# Autodesk Inventor assembly: MM0948AN170_G00_801
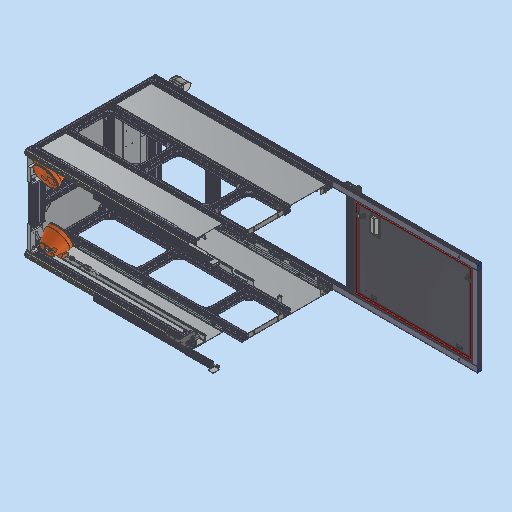
[picture p0: Inventor's stored thumbnail of the model, 512x512]
Saved by Autodesk Inventor 2023.3 (Build 273359000, 359)
## iProperties
RuleStatus: InUse
Created: 2021-06-24
Part Number: MM0948AN170_G00_801
Description: =<RBPARTNOTITLE2>
Document SubType Name: Assembly
Designer: frt9bw
Mass: 78853.5 g
Surface Area: 247356 cm^2
Volume: 30250.6 cm^3
Density: 2.60667 g/cm^3
AnP_Kategorie: 1
AnP_Material: =<Material>
AnP_TemplVers: 20200821
RBDOCUMENTTYPE: DRF
RBDOCUMENTVERSION: 00
RBDRAWINGMAINSCALE: 1:1
RBDRAWINGMISSINGSPEC: --
RBDRAWINGVOLUME: --
RBDSV1: 0850
RBGBEDGESIN1: +0,5
RBGBEDGESIN2: +0,2
RBGBEDGESOUT1: -0,3
RBGBEDGESOUT2: -0,1
RBMATERIAL: =<Material>
RBMATMEETS: --
RBMATNO: =<Part Number>
RBPARTMADEOF: --
RBPARTNO: SIEHE MNR
RBPARTNOTITLE1: manufactured part
RBPARTNOTITLE2: Blechsatz Einfachhaube
RBPARTSAFETYINDICATOR: --
RBSURFACE: --
RBSURFACE2: --
RBZEDGESNORM: ISO13715:2002-06
RBZGENDIMCLASS: m
RBZGENDIMNORM: ISO 2768-1:1989-11
RBZGENGEOCLASS: H
RBZGENGEONORM: ISO 2768-2:1989-11
RBZSURFACENORM: ISO13D2:2002-02
RBZTOLERANCENORM: ISO 14405-1:2010-12
Author: frt9bw
Keywords: =<RBPARTMADEOF>
Comments: =<RBSURFACE2>
Revision Number: 01
## Documents named in this file (19)
- C:\Users\rea9an\Documents\Inventor\TCAI2412_te1910_EM\AS00000962.iam
- C:\Users\rea9an\Documents\Inventor\TCAI2412_te1910_EM\PT00004288.ipt
- C:\Users\rea9an\Documents\Inventor\TCAI2412_te1910_EM\PT00004303.ipt
- C:\Users\rea9an\Documents\Inventor\TCAI2412_te1910_EM\PT00004480.ipt
- C:\Users\rea9an\Documents\Inventor\TCAI2412_te1910_EM\PT00004311.ipt
- C:\Users\rea9an\Documents\Inventor\TCAI2412_te1910_EM\PT00004406.ipt
- C:\Users\rea9an\Documents\Inventor\TCAI2412_te1910_EM\PT00004797.ipt
- C:\Users\rea9an\Documents\Inventor\TCAI2412_te1910_EM\PT00004798.ipt
- C:\Users\rea9an\Documents\Inventor\TCAI2412_te1910_EM\PT00004457.ipt
- C:\Users\rea9an\Documents\Inventor\TCAI2412_te1910_EM\PT00004800.ipt
- C:\Users\rea9an\Documents\Inventor\TCAI2412_te1910_EM\PT00004806.ipt
- C:\Users\rea9an\Documents\Inventor\TCAI2412_te1910_EM\PT00004456.ipt
- C:\Users\rea9an\Documents\Inventor\TCAI2412_te1910_EM\PT00004805.ipt
- C:\Users\rea9an\Documents\Inventor\TCAI2412_te1910_EM\PT00004804.ipt
- C:\Users\rea9an\Documents\Inventor\TCAI2412_te1910_EM\AS00000914.iam
- C:\Users\rea9an\Documents\Inventor\TCAI2412_te1910_EM\PT00004331.ipt
- C:\Users\rea9an\Documents\Inventor\TCAI2412_te1910_EM\AS00000920.iam
- C:\Users\rea9an\Documents\Inventor\TCAI2412_te1910_EM\PT00004702.ipt
- C:\Users\rea9an\Documents\Inventor\TCAI2412_te1910_EM\AS00000921.iam
## Components (145 placed, 18 different names)
1. PT00004702:1 — Fluchtend:6, Fluchtend:7, Passend:2, Fluchtend:10, Passend:4, Einfügen:2, Einfügen:11, Einfügen:12, Einfügen:13, Einfügen:14, Einfügen:15, Einfügen:33, Einfügen:34, Einfügen:35, Einfügen:36, Einfügen:37, Einfügen:38, Fluchtend:22, Fluchtend:24, Fluchtend:45, Fluchtend:58
2. PT00004702:2 — Fluchtend:15, Passend:7, Fluchtend:16, Fluchtend:17, Fluchtend:18, Einfügen:47, Einfügen:49, Einfügen:51, Einfügen:53, Einfügen:55, Einfügen:57, Einfügen:87, Einfügen:88, Einfügen:89, Einfügen:90, Einfügen:91, Einfügen:92, Fluchtend:22, Fluchtend:24, Passend:20
3. AS00000921:1 [sub-assembly] — Passend:35, Passend:38, Fluchtend:71, Fluchtend:72
4. AS00000914:1 [sub-assembly] — Fluchtend:27, Passend:13, Passend:14, Passend:30, Passend:32
5. PT00004797:1 — Fluchtend:1, Fluchtend:2, Fluchtend:3, Fluchtend:6, Fluchtend:7, Passend:2, Einfügen:16, Einfügen:17, Einfügen:18, Einfügen:26, Einfügen:29, Einfügen:32, Einfügen:39, Einfügen:41, Einfügen:43, Einfügen:45, Fluchtend:25, Fluchtend:40
6. PT00004798:1 — Fluchtend:1, Fluchtend:2, Fluchtend:3, Einfügen:27, Einfügen:28, Einfügen:30, Einfügen:31, Einfügen:40, Einfügen:42, Einfügen:44, Einfügen:46
7. PT00004797:2 — Passend:5, Passend:6, Fluchtend:11, Fluchtend:16, Fluchtend:17, Fluchtend:18, Einfügen:59, Einfügen:61, Einfügen:63, Einfügen:65, Einfügen:71, Einfügen:77, Einfügen:79, Einfügen:81, Einfügen:83, Einfügen:85, Fluchtend:20, Fluchtend:21, Fluchtend:25, Fluchtend:27, Passend:14, Fluchtend:42
8. PT00004798:2 — Passend:5, Passend:6, Fluchtend:11, Einfügen:67, Einfügen:69, Einfügen:73, Einfügen:75, Fluchtend:20, Fluchtend:21, Einfügen:93, Einfügen:94, Einfügen:95, Einfügen:96
9. PT00004457:1 — Fluchtend:34, Fluchtend:36, Fluchtend:44, Fluchtend:56
10. PT00004457:2 — Fluchtend:34, Passend:20, Fluchtend:36, Fluchtend:52, Fluchtend:57
11. PT00004800:1 — Passend:21, Fluchtend:39, Fluchtend:41, Einfügen:110, Einfügen:111, Einfügen:114, Einfügen:115, Einfügen:118, Einfügen:119, Einfügen:120, Einfügen:121, Passend:25, Passend:35
12. PT00004800:2 — Passend:21, Fluchtend:39, Fluchtend:40, Fluchtend:41, Fluchtend:42, Einfügen:112, Einfügen:113, Einfügen:116, Einfügen:117, Einfügen:126, Einfügen:127, Einfügen:128, Einfügen:129, Passend:26
13. PT00004806:1 — Passend:25, Fluchtend:45, Passend:26
14. PT00004456:1 — Fluchtend:52, Fluchtend:53, Fluchtend:54, Fluchtend:56
15. PT00004456:2 — Fluchtend:53, Fluchtend:54, Fluchtend:57, Fluchtend:58
16. PT00004805:1 — Passend:30
17. PT00004804:1 — Passend:32
18. PT00004456:4
19. PT00004456:3
20. AS00000920:1 [sub-assembly]
21. PT00004331:1 — Passend:38, Fluchtend:71, Fluchtend:72
22. PT00004480:15 — Einfügen:113
23. PT00004311:15
24. PT00004480:16 — Einfügen:112
25. PT00004311:16
26. PT00004480:17 — Einfügen:111
27. PT00004311:17
28. PT00004480:18 — Einfügen:110
29. PT00004311:18
30. PT00004480:19 — Einfügen:114
31. PT00004311:19
32. PT00004480:20 — Einfügen:117
33. PT00004311:20
34. PT00004480:21 — Einfügen:120
35. PT00004311:21
36. PT00004480:22 — Einfügen:121
37. PT00004311:22
38. PT00004480:23 — Einfügen:119
39. PT00004311:23
40. PT00004480:24 — Einfügen:118
41. PT00004311:24
42. PT00004480:25 — Einfügen:116
43. PT00004311:25
44. PT00004480:26 — Einfügen:115
45. PT00004311:26
46. PT00004480:27 — Einfügen:126
47. PT00004311:27
48. PT00004480:28 — Einfügen:128
49. PT00004311:28
50. PT00004480:29 — Einfügen:129
51. PT00004311:29
52. PT00004480:30 — Einfügen:127
53. PT00004311:30
54. PT00004406:15 — Einfügen:79
55. PT00004406:17 — Einfügen:81
56. PT00004406:19 — Einfügen:83
57. PT00004406:21 — Einfügen:85
58. PT00004406:23 — Einfügen:87
59. PT00004406:24 — Einfügen:88
60. PT00004406:25 — Einfügen:89
61. PT00004406:26 — Einfügen:90
62. PT00004406:27 — Einfügen:91
63. PT00004406:28 — Einfügen:92
64. PT00004406:29 — Einfügen:96
65. PT00004406:30 — Einfügen:95
66. PT00004406:31 — Einfügen:94
67. PT00004406:32 — Einfügen:93
68. PT00004303:10 — Einfügen:48
69. PT00004288:11 — Einfügen:47, Einfügen:48
70. PT00004303:11 — Einfügen:50
71. PT00004288:12 — Einfügen:49, Einfügen:50
72. PT00004303:12 — Einfügen:52
73. PT00004288:13 — Einfügen:51, Einfügen:52
74. PT00004303:13 — Einfügen:54
75. PT00004288:14 — Einfügen:53, Einfügen:54
76. PT00004303:14 — Einfügen:56
77. PT00004288:15 — Einfügen:55, Einfügen:56
78. PT00004303:15 — Einfügen:58
79. PT00004288:16 — Einfügen:57, Einfügen:58
80. PT00004303:16 — Einfügen:60
81. PT00004288:17 — Einfügen:59, Einfügen:60
82. PT00004303:17 — Einfügen:62
83. PT00004288:18 — Einfügen:61, Einfügen:62
84. PT00004303:18 — Einfügen:64
85. PT00004288:19 — Einfügen:63, Einfügen:64
86. PT00004480:8 — Einfügen:65, Einfügen:66
87. PT00004311:8 — Einfügen:66
88. PT00004480:9 — Einfügen:67, Einfügen:68
89. PT00004311:9 — Einfügen:68
90. PT00004480:10 — Einfügen:69, Einfügen:70
91. PT00004311:10 — Einfügen:70
92. PT00004480:11 — Einfügen:71, Einfügen:72
93. PT00004311:11 — Einfügen:72
94. PT00004480:12 — Einfügen:73, Einfügen:74
95. PT00004311:12 — Einfügen:74
96. PT00004480:13 — Einfügen:75, Einfügen:76
97. PT00004311:13 — Einfügen:76
98. PT00004480:14 — Einfügen:77, Einfügen:78
99. PT00004311:14 — Einfügen:78
100. PT00004303:1
101. PT00004288:2 — Einfügen:2
102. PT00004303:2
103. PT00004288:3 — Einfügen:12
104. PT00004303:3
105. PT00004288:4 — Einfügen:11
106. PT00004303:4
107. PT00004288:5 — Einfügen:13
108. PT00004303:5
109. PT00004288:6 — Einfügen:14
110. PT00004303:6
111. PT00004288:7 — Einfügen:15
112. PT00004303:7
113. PT00004288:8 — Einfügen:16
114. PT00004303:8
115. PT00004288:9 — Einfügen:17
116. PT00004303:9
117. PT00004288:10 — Einfügen:18
118. PT00004480:1 — Einfügen:32
119. PT00004311:1
120. PT00004480:2 — Einfügen:31
121. PT00004311:2
122. PT00004480:3 — Einfügen:30
123. PT00004311:3
124. PT00004480:4 — Einfügen:29
125. PT00004311:4
126. PT00004480:5 — Einfügen:28
127. PT00004311:5
128. PT00004480:6 — Einfügen:27
129. PT00004311:6
130. PT00004480:7 — Einfügen:26
131. PT00004311:7
132. PT00004406:1 — Einfügen:45
133. PT00004406:2 — Einfügen:46
134. PT00004406:3 — Einfügen:43
135. PT00004406:4 — Einfügen:44
136. PT00004406:5 — Einfügen:41
137. PT00004406:6 — Einfügen:42
138. PT00004406:7 — Einfügen:39
139. PT00004406:8 — Einfügen:40
140. PT00004406:9 — Einfügen:37
141. PT00004406:10 — Einfügen:38
142. PT00004406:11 — Einfügen:35
143. PT00004406:12 — Einfügen:36
144. PT00004406:13 — Einfügen:33
145. PT00004406:14 — Einfügen:34
## Relationships (185: Insert 124, Flush 42, Mate 19)
- Fluchtend:1 [Flush]: PT00004797:1 ↔ PT00004798:1
- Fluchtend:2 [Flush]: PT00004797:1 ↔ PT00004798:1
- Fluchtend:3 [Flush]: PT00004797:1 ↔ PT00004798:1
- Fluchtend:6 [Flush]: PT00004702:1 ↔ PT00004797:1
- Fluchtend:7 [Flush]: PT00004702:1 ↔ PT00004797:1
- Passend:2 [Mate] (377 mm): PT00004702:1 ↔ PT00004797:1
- Fluchtend:10 [Flush] (-365 mm): PT00004702:1
- Passend:4 [Mate] (-45 mm): PT00004702:1
- [Insert] (5 mm): PT00004303:1 ↔ PT00004288:2
- Einfügen:2 [Insert]: PT00004702:1 ↔ PT00004288:2
- [Insert] (5 mm): PT00004303:2 ↔ PT00004288:3
- [Insert] (5 mm): PT00004303:3 ↔ PT00004288:4
- [Insert] (5 mm): PT00004303:4 ↔ PT00004288:5
- [Insert] (5 mm): PT00004303:5 ↔ PT00004288:6
- [Insert] (5 mm): PT00004303:6 ↔ PT00004288:7
- [Insert] (5 mm): PT00004303:7 ↔ PT00004288:8
- [Insert] (5 mm): PT00004303:8 ↔ PT00004288:9
- [Insert] (5 mm): PT00004303:9 ↔ PT00004288:10
- Einfügen:11 [Insert]: PT00004702:1 ↔ PT00004288:4
- Einfügen:12 [Insert]: PT00004702:1 ↔ PT00004288:3
- Einfügen:13 [Insert]: PT00004702:1 ↔ PT00004288:5
- Einfügen:14 [Insert]: PT00004702:1 ↔ PT00004288:6
- Einfügen:15 [Insert]: PT00004702:1 ↔ PT00004288:7
- Einfügen:16 [Insert]: PT00004797:1 ↔ PT00004288:8
- Einfügen:17 [Insert]: PT00004797:1 ↔ PT00004288:9
- Einfügen:18 [Insert]: PT00004797:1 ↔ PT00004288:10
- [Insert] (5 mm): PT00004480:1 ↔ PT00004311:1
- [Insert] (5 mm): PT00004480:2 ↔ PT00004311:2
- [Insert] (5 mm): PT00004480:3 ↔ PT00004311:3
- [Insert] (5 mm): PT00004480:4 ↔ PT00004311:4
- [Insert] (5 mm): PT00004480:5 ↔ PT00004311:5
- [Insert] (5 mm): PT00004480:6 ↔ PT00004311:6
- [Insert] (5 mm): PT00004480:7 ↔ PT00004311:7
- Einfügen:26 [Insert]: PT00004797:1 ↔ PT00004480:7
- Einfügen:27 [Insert]: PT00004798:1 ↔ PT00004480:6
- Einfügen:28 [Insert]: PT00004798:1 ↔ PT00004480:5
- Einfügen:29 [Insert]: PT00004797:1 ↔ PT00004480:4
- Einfügen:30 [Insert]: PT00004798:1 ↔ PT00004480:3
- Einfügen:31 [Insert]: PT00004798:1 ↔ PT00004480:2
- Einfügen:32 [Insert]: PT00004797:1 ↔ PT00004480:1
- Einfügen:33 [Insert] (2 mm): PT00004702:1 ↔ PT00004406:13
- Einfügen:34 [Insert] (2 mm): PT00004702:1 ↔ PT00004406:14
- Einfügen:35 [Insert] (2 mm): PT00004702:1 ↔ PT00004406:11
- Einfügen:36 [Insert] (2 mm): PT00004702:1 ↔ PT00004406:12
- Einfügen:37 [Insert] (2 mm): PT00004702:1 ↔ PT00004406:9
- Einfügen:38 [Insert] (2 mm): PT00004702:1 ↔ PT00004406:10
- Einfügen:39 [Insert] (2 mm): PT00004797:1 ↔ PT00004406:7
- Einfügen:40 [Insert] (2 mm): PT00004798:1 ↔ PT00004406:8
- Einfügen:41 [Insert] (2 mm): PT00004797:1 ↔ PT00004406:5
- Einfügen:42 [Insert] (2 mm): PT00004798:1 ↔ PT00004406:6
- Einfügen:43 [Insert] (2 mm): PT00004797:1 ↔ PT00004406:3
- Einfügen:44 [Insert] (2 mm): PT00004798:1 ↔ PT00004406:4
- Einfügen:45 [Insert] (2 mm): PT00004797:1 ↔ PT00004406:1
- Einfügen:46 [Insert] (2 mm): PT00004798:1 ↔ PT00004406:2
- Passend:5 [Mate]: PT00004797:2 ↔ PT00004798:2
- Passend:6 [Mate]: PT00004797:2 ↔ PT00004798:2
- Fluchtend:11 [Flush]: PT00004797:2 ↔ PT00004798:2
- Fluchtend:15 [Flush] (-45 mm): PT00004702:2
- Passend:7 [Mate] (365 mm): PT00004702:2
- Fluchtend:16 [Flush] (377 mm): PT00004702:2 ↔ PT00004797:2
- Fluchtend:17 [Flush]: PT00004702:2 ↔ PT00004797:2
- Fluchtend:18 [Flush]: PT00004702:2 ↔ PT00004797:2
- Einfügen:47 [Insert]: PT00004702:2 ↔ PT00004288:11
- Einfügen:48 [Insert] (5 mm): PT00004303:10 ↔ PT00004288:11
- Einfügen:49 [Insert]: PT00004702:2 ↔ PT00004288:12
- Einfügen:50 [Insert] (5 mm): PT00004303:11 ↔ PT00004288:12
- Einfügen:51 [Insert]: PT00004702:2 ↔ PT00004288:13
- Einfügen:52 [Insert] (5 mm): PT00004303:12 ↔ PT00004288:13
- Einfügen:53 [Insert]: PT00004702:2 ↔ PT00004288:14
- Einfügen:54 [Insert] (5 mm): PT00004303:13 ↔ PT00004288:14
- Einfügen:55 [Insert]: PT00004702:2 ↔ PT00004288:15
- Einfügen:56 [Insert] (5 mm): PT00004303:14 ↔ PT00004288:15
- Einfügen:57 [Insert]: PT00004702:2 ↔ PT00004288:16
- Einfügen:58 [Insert] (5 mm): PT00004303:15 ↔ PT00004288:16
- Einfügen:59 [Insert]: PT00004797:2 ↔ PT00004288:17
- Einfügen:60 [Insert] (5 mm): PT00004303:16 ↔ PT00004288:17
- Einfügen:61 [Insert]: PT00004797:2 ↔ PT00004288:18
- Einfügen:62 [Insert] (5 mm): PT00004303:17 ↔ PT00004288:18
- Einfügen:63 [Insert]: PT00004797:2 ↔ PT00004288:19
- Einfügen:64 [Insert] (5 mm): PT00004303:18 ↔ PT00004288:19
- Einfügen:65 [Insert]: PT00004797:2 ↔ PT00004480:8
- Einfügen:66 [Insert] (5 mm): PT00004480:8 ↔ PT00004311:8
- Einfügen:67 [Insert]: PT00004798:2 ↔ PT00004480:9
- Einfügen:68 [Insert] (5 mm): PT00004480:9 ↔ PT00004311:9
- Einfügen:69 [Insert]: PT00004798:2 ↔ PT00004480:10
- Einfügen:70 [Insert] (5 mm): PT00004480:10 ↔ PT00004311:10
- Einfügen:71 [Insert]: PT00004797:2 ↔ PT00004480:11
- Einfügen:72 [Insert] (5 mm): PT00004480:11 ↔ PT00004311:11
- Einfügen:73 [Insert]: PT00004798:2 ↔ PT00004480:12
- Einfügen:74 [Insert] (5 mm): PT00004480:12 ↔ PT00004311:12
- Einfügen:75 [Insert]: PT00004798:2 ↔ PT00004480:13
- Einfügen:76 [Insert] (5 mm): PT00004480:13 ↔ PT00004311:13
- Einfügen:77 [Insert]: PT00004797:2 ↔ PT00004480:14
- Einfügen:78 [Insert] (5 mm): PT00004480:14 ↔ PT00004311:14
- Einfügen:79 [Insert] (2 mm): PT00004797:2 ↔ PT00004406:15
- Einfügen:81 [Insert] (2 mm): PT00004797:2 ↔ PT00004406:17
- Einfügen:83 [Insert] (2 mm): PT00004797:2 ↔ PT00004406:19
- Einfügen:85 [Insert] (2 mm): PT00004797:2 ↔ PT00004406:21
- Einfügen:87 [Insert] (2 mm): PT00004702:2 ↔ PT00004406:23
- Einfügen:88 [Insert] (2 mm): PT00004702:2 ↔ PT00004406:24
- Einfügen:89 [Insert] (2 mm): PT00004702:2 ↔ PT00004406:25
- Einfügen:90 [Insert] (2 mm): PT00004702:2 ↔ PT00004406:26
- Einfügen:91 [Insert] (2 mm): PT00004702:2 ↔ PT00004406:27
- Einfügen:92 [Insert] (2 mm): PT00004702:2 ↔ PT00004406:28
- Fluchtend:20 [Flush]: PT00004797:2 ↔ PT00004798:2
- Fluchtend:21 [Flush]: PT00004797:2 ↔ PT00004798:2
- Fluchtend:22 [Flush]: PT00004702:1 ↔ PT00004702:2
- Fluchtend:24 [Flush]: PT00004702:1 ↔ PT00004702:2
- Einfügen:93 [Insert] (2 mm): PT00004798:2 ↔ PT00004406:32
- Einfügen:94 [Insert] (2 mm): PT00004798:2 ↔ PT00004406:31
- Einfügen:95 [Insert] (2 mm): PT00004798:2 ↔ PT00004406:30
- Einfügen:96 [Insert] (2 mm): PT00004798:2 ↔ PT00004406:29
- Fluchtend:25 [Flush]: PT00004797:1 ↔ PT00004797:2
- Fluchtend:27 [Flush]: AS00000914:1 ↔ PT00004797:2
- Passend:13 [Mate]: AS00000914:1
- Passend:14 [Mate] (45 mm): AS00000914:1 ↔ PT00004797:2
- Fluchtend:34 [Flush]: PT00004457:1 ↔ PT00004457:2
- Passend:20 [Mate] (45 mm): PT00004702:2 ↔ PT00004457:2
- Fluchtend:36 [Flush]: PT00004457:1 ↔ PT00004457:2
- Passend:21 [Mate]: PT00004800:1 ↔ PT00004800:2
- Fluchtend:39 [Flush]: PT00004800:1 ↔ PT00004800:2
- Fluchtend:40 [Flush] (-47 mm): PT00004797:1 ↔ PT00004800:2
- Fluchtend:41 [Flush]: PT00004800:1 ↔ PT00004800:2
- Fluchtend:42 [Flush] (2 mm): PT00004797:2 ↔ PT00004800:2
- [Insert] (5 mm): PT00004480:15 ↔ PT00004311:15
- [Insert] (5 mm): PT00004480:16 ↔ PT00004311:16
- [Insert] (5 mm): PT00004480:17 ↔ PT00004311:17
- [Insert] (5 mm): PT00004480:18 ↔ PT00004311:18
- [Insert] (5 mm): PT00004480:19 ↔ PT00004311:19
- [Insert] (5 mm): PT00004480:20 ↔ PT00004311:20
- [Insert] (5 mm): PT00004480:21 ↔ PT00004311:21
- [Insert] (5 mm): PT00004480:22 ↔ PT00004311:22
- [Insert] (5 mm): PT00004480:23 ↔ PT00004311:23
- [Insert] (5 mm): PT00004480:24 ↔ PT00004311:24
- [Insert] (5 mm): PT00004480:25 ↔ PT00004311:25
- [Insert] (5 mm): PT00004480:26 ↔ PT00004311:26
- Einfügen:110 [Insert]: PT00004800:1 ↔ PT00004480:18
- Einfügen:111 [Insert]: PT00004800:1 ↔ PT00004480:17
- Einfügen:112 [Insert]: PT00004800:2 ↔ PT00004480:16
- Einfügen:113 [Insert]: PT00004800:2 ↔ PT00004480:15
- Einfügen:114 [Insert]: PT00004800:1 ↔ PT00004480:19
- Einfügen:115 [Insert]: PT00004800:1 ↔ PT00004480:26
- Einfügen:116 [Insert]: PT00004800:2 ↔ PT00004480:25
- Einfügen:117 [Insert]: PT00004800:2 ↔ PT00004480:20
- Einfügen:118 [Insert]: PT00004800:1 ↔ PT00004480:24
- Einfügen:119 [Insert]: PT00004800:1 ↔ PT00004480:23
- Einfügen:120 [Insert]: PT00004800:1 ↔ PT00004480:21
- Einfügen:121 [Insert]: PT00004800:1 ↔ PT00004480:22
- [Insert] (5 mm): PT00004480:27 ↔ PT00004311:27
- [Insert] (5 mm): PT00004480:28 ↔ PT00004311:28
- [Insert] (5 mm): PT00004480:29 ↔ PT00004311:29
- [Insert] (5 mm): PT00004480:30 ↔ PT00004311:30
- Einfügen:126 [Insert]: PT00004800:2 ↔ PT00004480:27
- Einfügen:127 [Insert]: PT00004800:2 ↔ PT00004480:30
- Einfügen:128 [Insert]: PT00004800:2 ↔ PT00004480:28
- Einfügen:129 [Insert]: PT00004800:2 ↔ PT00004480:29
- Fluchtend:44 [Flush]: PT00004457:1
- Passend:25 [Mate]: PT00004800:1 ↔ PT00004806:1
- Fluchtend:45 [Flush] (45 mm): PT00004702:1 ↔ PT00004806:1
- Passend:26 [Mate] (3 mm): PT00004800:2 ↔ PT00004806:1
- Fluchtend:52 [Flush]: PT00004457:2 ↔ PT00004456:1
- Fluchtend:53 [Flush]: PT00004456:1 ↔ PT00004456:2
- Fluchtend:54 [Flush]: PT00004456:1 ↔ PT00004456:2
- Fluchtend:56 [Flush] (10 mm): PT00004457:1 ↔ PT00004456:1
- Fluchtend:57 [Flush] (10 mm): PT00004457:2 ↔ PT00004456:2
- Fluchtend:58 [Flush]: PT00004702:1 ↔ PT00004456:2
- Passend:30 [Mate]: AS00000914:1 ↔ PT00004805:1
- Passend:32 [Mate]: AS00000914:1 ↔ PT00004804:1
- [Flush]: AS00000921:1 ↔ PT00004797:2
- [Mate]: AS00000921:1 ↔ PT00004457:1
- [Flush]: AS00000921:1 ↔ PT00004457:1
- [Mate]: AS00000921:1 ↔ PT00004797:2
- [Flush]: PT00004702:2 ↔ PT00004456:3
- [Flush]: PT00004457:1 ↔ PT00004456:3
- [Flush] (10 mm): PT00004457:1 ↔ PT00004456:3
- [Flush]: PT00004456:4 ↔ PT00004456:3
- [Flush]: PT00004456:4 ↔ PT00004456:3
- [Flush] (10 mm): PT00004457:2 ↔ PT00004456:4
- Passend:35 [Mate]: AS00000921:1 ↔ PT00004800:1
- Passend:38 [Mate]: AS00000921:1 ↔ PT00004331:1
- Fluchtend:71 [Flush]: AS00000921:1 ↔ PT00004331:1
- Fluchtend:72 [Flush]: AS00000921:1 ↔ PT00004331:1
- [Mate]: AS00000921:1 ↔ AS00000920:1
- [Mate] (7.5 mm): AS00000921:1 ↔ AS00000920:1
- [Flush] (115 mm): AS00000921:1 ↔ AS00000920:1
## Named parameters: d653_d637_d631 = 5 mm, d17_d653_d637_d631 = 5 mm, d18_d653_d637_d631 = 5 mm, d19_d653_d637_d631 = 5 mm, d20_d653_d637_d631 = 5 mm, d21_d653_d637_d631 = 5 mm, d22_d653_d637_d631 = 5 mm, d23_d653_d637_d631 = 5 mm, d24_d653_d637_d631 = 5 mm, d725_d707 = 5 mm, d34_d725_d707 = 5 mm, d35_d725_d707 = 5 mm, d36_d725_d707 = 5 mm, d37_d725_d707 = 5 mm, d38_d725_d707 = 5 mm, d39_d725_d707 = 5 mm, d171_d34_d725_d707 = 5 mm, d172_d34_d725_d707 = 5 mm, d173_d34_d725_d707 = 5 mm, d174_d34_d725_d707 = 5 mm, d175_d34_d725_d707 = 5 mm, d176_d34_d725_d707 = 5 mm, d177_d34_d725_d707 = 5 mm, d178_d34_d725_d707 = 5 mm, d179_d34_d725_d707 = 5 mm, d180_d34_d725_d707 = 5 mm, d181_d34_d725_d707 = 5 mm, d182_d34_d725_d707 = 5 mm, d195_d34_d725_d707 = 5 mm, d196_d34_d725_d707 = 5 mm, d197_d34_d725_d707 = 5 mm, d198_d34_d725_d707 = 5 mm, d264_d16 = 0 mm, d269_d7 = 0 mm, d270_d8 = 0 mm
